# Autodesk Inventor assembly: Seals_280x292_280
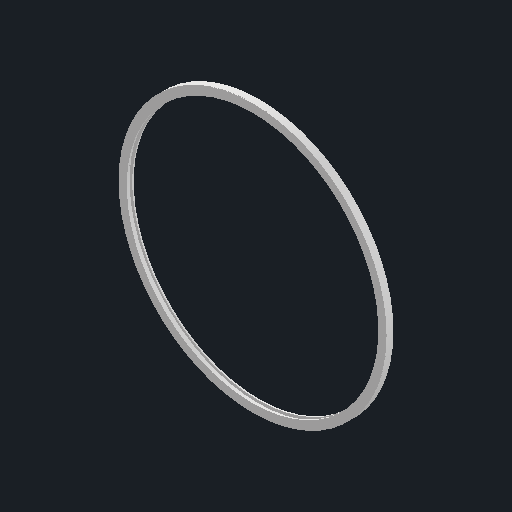
[picture p0: Inventor's stored thumbnail of the model, 512x512]
Saved by Autodesk Inventor 2027.2 (Build 312334000, 334)
## iProperties
Created: 2026-11-16
Part Number: Seals_280x292_280
Document SubType Name: Assembly
Designer: Gasteng5
Author: Gasteng5
## Documents named in this file (3)
- C:\Users\Gasteng5\Documents\ilogic2027\Seals\Outputs\een\Sillicone-Si-blue\Seals_280x292_280.iam
- C:\Users\Gasteng5\Documents\ilogic2027\Seals\Outputs\een\Sillicone-Si-blue\SealIn_280x292_280.ipt
- C:\Users\Gasteng5\Documents\ilogic2027\Seals\Outputs\een\Sillicone-Si-blue\SealOut_280x292_280.ipt
## Components (2 placed, 2 different names)
1. SealOut_280x292_280:1 — Mate:1, Mate:2, Mate:3
2. SealIn_280x292_280:1 — Mate:4, Mate:5, Mate:6
## Relationships (6: Mate 6)
- Mate:1: SealOut_280x292_280:1
- Mate:2: SealOut_280x292_280:1
- Mate:3: SealOut_280x292_280:1
- Mate:4: SealIn_280x292_280:1
- Mate:5: SealIn_280x292_280:1
- Mate:6: SealIn_280x292_280:1
